# Autodesk Inventor assembly: ASY DMF-2000 Sludge Tray
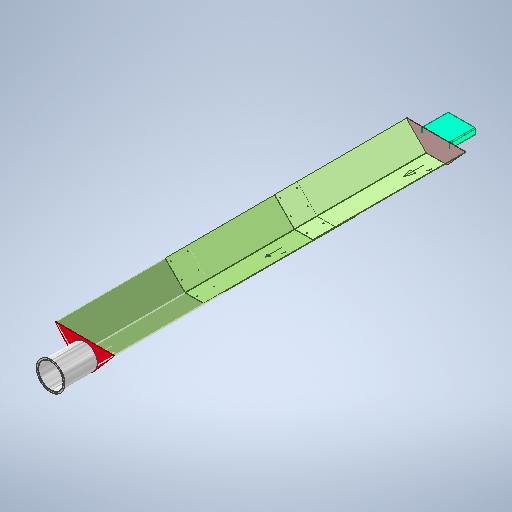
[picture p0: Inventor's stored thumbnail of the model, 512x512]
Saved by Autodesk Inventor 2026.2 (Build 302298000, 298)
## iProperties
Created: 2024-05-14
Part Number: ASY DMF-2000 Sludge Tray
Document SubType Name: Assembly
Designer: admin
Stock Number: DMF-2000
Author: admin
## Documents named in this file (9)
- C:\Users\admin\Documents\Inventor\DMF-Disk-Micro-Filter\ASY DMF-2000 Sludge Tray.iam
- C:\Users\admin\Documents\Inventor\DMF-Disk-Micro-Filter\DMF-2001 Tray 01.ipt
- C:\Users\admin\Documents\Inventor\DMF-Disk-Micro-Filter\DMF-2002 Tray End Stern.ipt
- C:\Users\admin\Documents\Inventor\DMF-Disk-Micro-Filter\DMF-2003 Tray Channel 01.ipt
- C:\Users\admin\Documents\Inventor\DMF-Disk-Micro-Filter\DMF-2004 Tray Flange.ipt
- C:\Users\admin\Documents\Inventor\DMF-Disk-Micro-Filter\DMF-2010 Sludge Pipe 02.ipt
- C:\Users\admin\Documents\Inventor\DMF-Disk-Micro-Filter\Барабан v2.1\DMF-1212 Gear Ring 03.ipt
- C:\Users\admin\Documents\Inventor\DMF-Disk-Micro-Filter\DMF-2007 Tray 02.ipt
- C:\Users\admin\Documents\Inventor\DMF-Disk-Micro-Filter\DMF-2008 Tray 03.ipt
## Components (8 placed, 8 different names)
1. DMF-2001 Tray 01:1 — Mate:2, Mate:3, Mate:4, Flush:3, Flush:4, Mate:7, Mate:9, Mate:10, Mate:11
2. DMF-2002 Tray End Stern:1 — Rigid:2, Rigid:5
3. DMF-2003 Tray Channel 01:1 — Rigid:2
4. DMF-2010 Sludge Pipe 02:1 — Rigid:3, Rigid:4
5. DMF-2004 Tray Flange:1 — Rigid:3, Mate:2, Mate:3, Mate:4, Flush:3, Mate:8
6. DMF-1212 Gear Ring 03:1 — Rigid:4
7. DMF-2007 Tray 02:1 — Mate:9, Mate:10, Mate:11, Mate:12, Mate:13, Mate:14
8. DMF-2008 Tray 03:1 — Mate:12, Mate:13, Mate:14, Rigid:5
## Relationships (17: Mate 11, WeldJoint 4, Flush 2)
- Rigid:2 [WeldJoint]: DMF-2002 Tray End Stern:1 ↔ DMF-2003 Tray Channel 01:1
- Rigid:3 [WeldJoint]: DMF-2010 Sludge Pipe 02:1 ↔ DMF-2004 Tray Flange:1
- Mate:2: DMF-2001 Tray 01:1 ↔ DMF-2004 Tray Flange:1
- Mate:3: DMF-2001 Tray 01:1 ↔ DMF-2004 Tray Flange:1
- Mate:4: DMF-2001 Tray 01:1 ↔ DMF-2004 Tray Flange:1
- Flush:3: DMF-2001 Tray 01:1 ↔ DMF-2004 Tray Flange:1
- Flush:4: DMF-2001 Tray 01:1
- Mate:7: DMF-2001 Tray 01:1
- Mate:8: DMF-2004 Tray Flange:1
- Rigid:4 [WeldJoint]: DMF-2010 Sludge Pipe 02:1 ↔ DMF-1212 Gear Ring 03:1
- Mate:9: DMF-2001 Tray 01:1 ↔ DMF-2007 Tray 02:1
- Mate:10: DMF-2001 Tray 01:1 ↔ DMF-2007 Tray 02:1
- Mate:11: DMF-2001 Tray 01:1 ↔ DMF-2007 Tray 02:1
- Mate:12: DMF-2007 Tray 02:1 ↔ DMF-2008 Tray 03:1
- Mate:13: DMF-2007 Tray 02:1 ↔ DMF-2008 Tray 03:1
- Mate:14: DMF-2007 Tray 02:1 ↔ DMF-2008 Tray 03:1
- Rigid:5 [WeldJoint]: DMF-2002 Tray End Stern:1 ↔ DMF-2008 Tray 03:1
